# Autodesk Inventor assembly: StandRobot
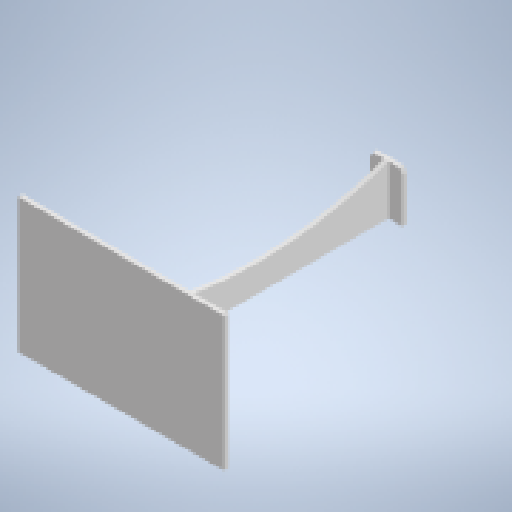
[picture p0: Inventor's stored thumbnail of the model, 512x512]
Saved by Autodesk Inventor 2025.2 (Build 292293000, 293)
## iProperties
Created: 2025-07-03
Part Number: StandRobot
Document SubType Name: Assembly
Designer: ricoa
Author: ricoa
## Documents named in this file (4)
- C:\Users\ricoa\OneDrive\Desktop\PROYEK AKHIR\project_pororo\Stand\StandRobot.iam
- C:\Users\ricoa\OneDrive\Desktop\PROYEK AKHIR\project_pororo\Stand\StandTop.ipt
- C:\Users\ricoa\OneDrive\Desktop\PROYEK AKHIR\project_pororo\Stand\StandMain.ipt
- C:\Users\ricoa\OneDrive\Desktop\PROYEK AKHIR\project_pororo\Stand\StandBottom.ipt
## Components (3 placed, 3 different names)
1. StandTop:1 — Mate:1, Mate:2
2. StandMain:1 — Mate:1, Mate:2, Flush:1, Mate:3, Mate:4
3. StandBottom:1 — Flush:1, Mate:3, Mate:4
## Relationships (5: Mate 4, Flush 1)
- Mate:1: StandTop:1 ↔ StandMain:1
- Mate:2: StandTop:1 ↔ StandMain:1
- Flush:1: StandMain:1 ↔ StandBottom:1
- Mate:3: StandMain:1 ↔ StandBottom:1
- Mate:4: StandMain:1 ↔ StandBottom:1
